# Autodesk Inventor assembly: WoodenHaptics_PROTOTIPO_MDF_R1
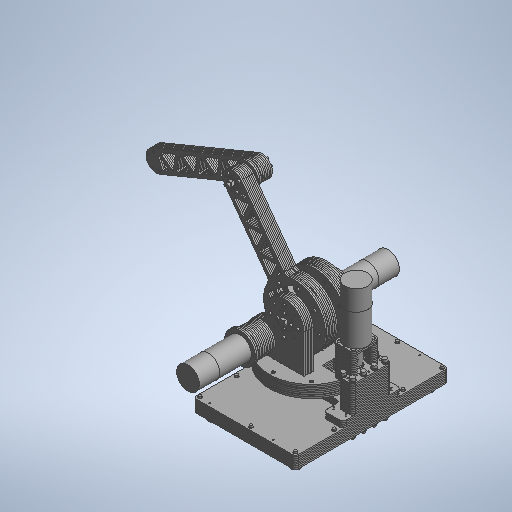
[picture p0: Inventor's stored thumbnail of the model, 512x512]
Saved by Autodesk Inventor 2027.1 (Build 311270010, 270A)
## iProperties
RuleStatus: InUse
Part Number: WoodenHaptics_PROTOTIPO_MDF_R1
Document SubType Name: Ensamblaje
Designer: VicenteRealValpo
Author: VicenteRealValpo
## Documents named in this file (6)
- C:\Users\VicenteRealValpo\Documents\FONDEF\WoodenHaptics\Prototipo_MDF_20261111\CAD\WoodenHaptics_PROTOTIPO_MDF_R1.iam
- C:\Users\VicenteRealValpo\Documents\FONDEF\WoodenHaptics\Prototipo_MDF_20261111\CAD\Cuerpo_Base.iam
- C:\Users\VicenteRealValpo\Documents\FONDEF\WoodenHaptics\Prototipo_MDF_20261111\CAD\Cuerpo_A.iam
- C:\Users\VicenteRealValpo\Documents\FONDEF\WoodenHaptics\Prototipo_MDF_20261111\CAD\Cuerpo_B.iam
- C:\Users\VicenteRealValpo\Documents\FONDEF\WoodenHaptics\Prototipo_MDF_20261111\CAD\Cuerpo_C.iam
- C:\Users\VicenteRealValpo\Documents\FONDEF\WoodenHaptics\Prototipo_MDF_20261111\CAD\Cuerpo_Cprima.iam
## Components (5 placed, 5 different names)
1. Cuerpo_Base [sub-assembly] — Articulacion_Base_eje, Articulacion_Base_axial, CONTROL_1_Giro_base
2. Cuerpo_A [sub-assembly] — Articulacion_Base_eje, Articulacion_Base_axial, Articulacion_Hombro_eje, Articulacion_Hombro_axial, Articulacion_Cprima_eje, Articulacion_Cprima_axial, CONTROL_1_Giro_base, CONTROL_2_Brazo_B, CONTROL_3_Orientacion_C
3. Cuerpo_B [sub-assembly] — Articulacion_Hombro_eje, Articulacion_Hombro_axial, Articulacion_Codo_eje, Articulacion_Codo_axial, CONTROL_2_Brazo_B
4. Cuerpo_C [sub-assembly] — Articulacion_Codo_eje, Articulacion_Codo_axial, Transmision_Cprima_C_1a1
5. Cuerpo_Cprima [sub-assembly] — Articulacion_Cprima_eje, Articulacion_Cprima_axial, Transmision_Cprima_C_1a1, CONTROL_3_Orientacion_C
## Relationships (12: Mate 4, Flush 4, Angle 3, RelateRotation 1)
- Articulacion_Base_eje [Mate]: Cuerpo_Base ↔ Cuerpo_A
- Articulacion_Base_axial [Flush]: Cuerpo_Base ↔ Cuerpo_A
- Articulacion_Hombro_eje [Mate]: Cuerpo_A ↔ Cuerpo_B
- Articulacion_Hombro_axial [Flush]: Cuerpo_A ↔ Cuerpo_B
- Articulacion_Cprima_eje [Mate]: Cuerpo_A ↔ Cuerpo_Cprima
- Articulacion_Cprima_axial [Flush]: Cuerpo_A ↔ Cuerpo_Cprima
- Articulacion_Codo_eje [Mate]: Cuerpo_B ↔ Cuerpo_C
- Articulacion_Codo_axial [Flush]: Cuerpo_B ↔ Cuerpo_C
- Transmision_Cprima_C_1a1 [RelateRotation] (1 ul): Cuerpo_C ↔ Cuerpo_Cprima
- CONTROL_1_Giro_base [Angle] (0 deg): Cuerpo_Base ↔ Cuerpo_A
- CONTROL_2_Brazo_B [Angle] (0 deg): Cuerpo_A ↔ Cuerpo_B
- CONTROL_3_Orientacion_C [Angle] (0 deg): Cuerpo_A ↔ Cuerpo_Cprima
